# Autodesk Inventor assembly: Soft_Gripper
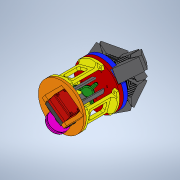
[picture p0: Inventor's stored thumbnail of the model, 180x180]
Saved by Autodesk Inventor 2021 (Build 250183000, 183)
## iProperties
Created: 2026-04-21
Part Number: Soft_Gripper
Document SubType Name: Assembly
Designer: Admin
Author: Admin
## Documents named in this file (13)
- C:\Users\Admin\Desktop\Università\MAGISTRALE\Y2_S2\SOFT ROBOTIC\Project\Model\V10\Soft_Gripper.iam
- C:\Users\Admin\Desktop\Università\MAGISTRALE\Y2_S2\SOFT ROBOTIC\Project\Model\V10\Base.ipt
- C:\Users\Admin\Desktop\Università\MAGISTRALE\Y2_S2\SOFT ROBOTIC\Project\Model\V10\Finger\Moving_Finger.iam
- C:\Users\Admin\Desktop\Università\MAGISTRALE\Y2_S2\SOFT ROBOTIC\Project\Model\V10\Base_Closure.ipt
- C:\Users\Admin\Desktop\Università\MAGISTRALE\Y2_S2\SOFT ROBOTIC\Project\Model\V6\Object.ipt
- C:\Users\Admin\Desktop\Università\MAGISTRALE\Y2_S2\SOFT ROBOTIC\Project\Model\V10\Closure.ipt
- C:\Users\Admin\Desktop\Università\MAGISTRALE\Y2_S2\SOFT ROBOTIC\Project\Model\V10\Lateral Support.ipt
- C:\Users\Admin\Desktop\Università\MAGISTRALE\Y2_S2\SOFT ROBOTIC\Project\Model\V10\Whippletree.ipt
- C:\Users\Admin\Desktop\Università\MAGISTRALE\Y2_S2\SOFT ROBOTIC\Project\Model\V10\Palm_Support.ipt
- C:\Users\Admin\Desktop\Università\MAGISTRALE\Y2_S2\SOFT ROBOTIC\Project\Model\V10\Palm.ipt
- C:\Users\Admin\Desktop\Università\MAGISTRALE\Y2_S2\SOFT ROBOTIC\Project\Model\V10\amewi_6208mg.STEP.iam
- C:\Users\Admin\Desktop\Università\MAGISTRALE\Y2_S2\SOFT ROBOTIC\Project\Model\V9\Pullay3.ipt
- C:\Users\Admin\Desktop\Università\MAGISTRALE\Y2_S2\SOFT ROBOTIC\Project\Model\V10\Staffa.ipt
## Components (18 placed, 12 different names)
1. Base:1 — Mate:1, Mate:2, Mate:3, Mate:4, Mate:5, Angle:1, Mate:6, Mate:8, Mate:9, Mate:10, Mate:12, Angle:2, Mate:17, Mate:23, Mate:24, Mate:25
2. Object:1 — Mate:4, Tangent:1
3. Base_Closure:1 — Mate:5, Angle:1, Mate:6, Mate:13, Mate:14
4. Closure:1 — Mate:8, Angle:2, Mate:18, Mate:19, Flush:1, Angle:3, Mate:22
5. Whippletree:1 — Mate:12
6. Palm_Support:1 — Mate:13, Mate:14, Mate:15, Mate:16
7. Palm:1 — Mate:15, Mate:16, Tangent:1
8. amewi_6208mg.STEP:1 [sub-assembly] — Mate:19, Mate:20, Mate:21, Angle:3, Mate:22
9. Pullay3:1 — Mate:20, Mate:21, Flush:1
10. Moving_Finger:1 [sub-assembly] — Mate:1, Mate:2, Mate:3
11. Moving_Finger:2 [sub-assembly]
12. Moving_Finger:3 [sub-assembly]
13. Lateral Support:1 — Mate:9, Mate:10, Mate:17
14. Lateral Support:2 — Mate:18
15. Lateral Support:3
16. Staffa:1 — Mate:23, Mate:24, Mate:25
17. Staffa:2
18. Staffa:3
## Component patterns: (3 elements, first: Moving_Finger:1), (3 elements, first: Lateral Support:1), (3 elements, first: Staffa:1)
## Relationships (28: Mate 23, Angle 3, Tangent 1, Flush 1)
- Mate:1: Base:1 ↔ Moving_Finger:1
- Mate:2: Base:1 ↔ Moving_Finger:1
- Mate:3: Base:1 ↔ Moving_Finger:1
- Mate:4: Base:1 ↔ Object:1
- Mate:5: Base:1 ↔ Base_Closure:1
- Angle:1 (0 deg): Base:1 ↔ Base_Closure:1
- Mate:6: Base:1 ↔ Base_Closure:1
- Mate:8: Base:1 ↔ Closure:1
- Mate:9: Base:1 ↔ Lateral Support:1
- Mate:10: Base:1 ↔ Lateral Support:1
- Mate:12: Base:1 ↔ Whippletree:1
- Angle:2 (216 deg): Base:1 ↔ Closure:1
- Mate:13: Base_Closure:1 ↔ Palm_Support:1
- Mate:14: Base_Closure:1 ↔ Palm_Support:1
- Mate:15: Palm_Support:1 ↔ Palm:1
- Mate:16: Palm_Support:1 ↔ Palm:1
- Tangent:1: Object:1 ↔ Palm:1
- Mate:17: Base:1 ↔ Lateral Support:1
- Mate:18: Closure:1 ↔ Lateral Support:2
- Mate:19: Closure:1 ↔ amewi_6208mg.STEP:1
- Mate:20: amewi_6208mg.STEP:1 ↔ Pullay3:1
- Mate:21 (6 mm): amewi_6208mg.STEP:1 ↔ Pullay3:1
- Flush:1 (17 mm): Closure:1 ↔ Pullay3:1
- Angle:3 (90 deg): Closure:1 ↔ amewi_6208mg.STEP:1
- Mate:22: Closure:1 ↔ amewi_6208mg.STEP:1
- Mate:23: Base:1 ↔ Staffa:1
- Mate:24: Base:1 ↔ Staffa:1
- Mate:25: Base:1 ↔ Staffa:1
